# Autodesk Inventor assembly: End Effector Platform
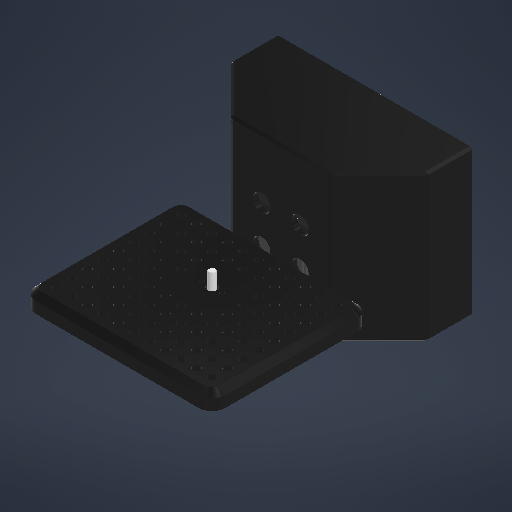
[picture p0: Inventor's stored thumbnail of the model, 512x512]
Saved by Autodesk Inventor 2027 (Build 310192060, 192F)
## iProperties
Created: 2026-08-17
Part Number: End Effector Platform
Document SubType Name: Assembly
Designer: Oasis
Author: Oasis
## Documents named in this file (8)
- C:\Users\Oasis\Documents\Work\ENGINEER 1P13 RA Position (2025 - 2026)\QArm Improvements\End Effector Platform\End Effector Platform.iam
- C:\Users\Oasis\Documents\Work\ENGINEER 1P13 RA Position (2025 - 2026)\QArm Improvements\End Effector Platform\End Effector Platform Base.ipt
- C:\Users\Oasis\Documents\Work\ENGINEER 1P13 RA Position (2025 - 2026)\QArm Improvements\End Effector Platform\End Effector Platform Compartment Lid.ipt
- C:\Users\Oasis\Documents\Work\ENGINEER 1P13 RA Position (2025 - 2026)\QArm Improvements\End Effector Platform\End Effector Platform.ipt
- C:\Users\Oasis\Documents\Work\ENGINEER 1P13 RA Position (2025 - 2026)\QArm Improvements\End Effector Platform\Gripper Motor Cover.ipt
- C:\Users\Oasis\Documents\Work\ENGINEER 1P13 RA Position (2025 - 2026)\QArm Improvements\End Effector Platform\N20 Mini Micro Metall Gear Motor DC 3-6-12V v1 v1.ipt
- C:\Users\Oasis\Documents\Work\ENGINEER 1P13 RA Position (2025 - 2026)\QArm Improvements\End Effector Platform\XC-430_idle v3.iam
- C:\Users\Oasis\Documents\Work\ENGINEER 1P13 RA Position (2025 - 2026)\QArm Improvements\End Effector Platform\Quanser QUARC EE Board.ipt
## Components (7 placed, 7 different names)
1. End Effector Platform Base:1 — Mate:1, Mate:2, Mate:3, Mate:4, Mate:5, Mate:6, Flush:1, Flush:2, Mate:7, Mate:8, Mate:9, Flush:3, Mate:10, Mate:11, Mate:12, Mate:13, Mate:14
2. End Effector Platform Compartment Lid:1 — Flush:1, Flush:2, Mate:7
3. End Effector Platform:1 — Mate:10, Mate:11, Mate:12, Mate:15
4. Gripper Motor Cover:1 — Mate:13, Mate:14, Mate:15
5. N20 Mini Micro Metall Gear Motor DC 3-6-12V v1 v1:1 — Mate:8, Mate:9, Flush:3
6. XC-430_idle v3:1 [sub-assembly] — Mate:1, Mate:2, Mate:3
7. Quanser QUARC EE Board:1 — Mate:4, Mate:5, Mate:6
## Relationships (18: Mate 15, Flush 3)
- Mate:1: End Effector Platform Base:1 ↔ XC-430_idle v3:1
- Mate:2: End Effector Platform Base:1 ↔ XC-430_idle v3:1
- Mate:3: End Effector Platform Base:1 ↔ XC-430_idle v3:1
- Mate:4: End Effector Platform Base:1 ↔ Quanser QUARC EE Board:1
- Mate:5: End Effector Platform Base:1 ↔ Quanser QUARC EE Board:1
- Mate:6: End Effector Platform Base:1 ↔ Quanser QUARC EE Board:1
- Flush:1: End Effector Platform Base:1 ↔ End Effector Platform Compartment Lid:1
- Flush:2: End Effector Platform Base:1 ↔ End Effector Platform Compartment Lid:1
- Mate:7: End Effector Platform Base:1 ↔ End Effector Platform Compartment Lid:1
- Mate:8 (0.2 mm): End Effector Platform Base:1 ↔ N20 Mini Micro Metall Gear Motor DC 3-6-12V v1 v1:1
- Mate:9 (0.2 mm): End Effector Platform Base:1 ↔ N20 Mini Micro Metall Gear Motor DC 3-6-12V v1 v1:1
- Flush:3: End Effector Platform Base:1 ↔ N20 Mini Micro Metall Gear Motor DC 3-6-12V v1 v1:1
- Mate:10 (0.1 mm): End Effector Platform Base:1 ↔ End Effector Platform:1
- Mate:11 (0.1 mm): End Effector Platform Base:1 ↔ End Effector Platform:1
- Mate:12: End Effector Platform Base:1 ↔ End Effector Platform:1
- Mate:13 (0.01 mm): End Effector Platform Base:1 ↔ Gripper Motor Cover:1
- Mate:14 (0.01 mm): End Effector Platform Base:1 ↔ Gripper Motor Cover:1
- Mate:15: End Effector Platform:1 ↔ Gripper Motor Cover:1
